# Autodesk Inventor assembly: Upright_Assembly_V2
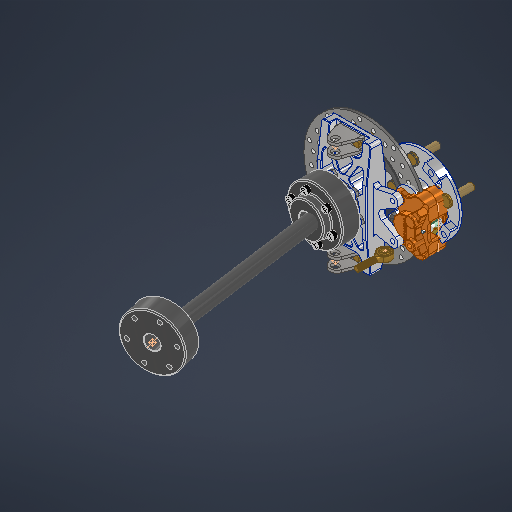
[picture p0: Inventor's stored thumbnail of the model, 512x512]
Saved by Autodesk Inventor 2027.1 (Build 311270010, 270A)
## iProperties
Created: 2026-10-10
Part Number: Upright_Assembly_V2
Document SubType Name: Assembly
Designer: share
Author: share
## Documents named in this file (21)
- C:\Users\share\OneDrive\Documents\Personal Projects\GOGO Kart\CAD\GOGO_KART_FSAE\Suspension - Shareef\Final Suspension Parts\REAL Upright\V2\Upright_Assembly_V2.iam
- C:\Users\share\OneDrive\Documents\Personal Projects\GOGO Kart\CAD\GOGO_KART_FSAE\Suspension - Shareef\Final Suspension Parts\REAL Upright\V2\grainger-35hz68.ipt
- C:\Users\share\OneDrive\Documents\Personal Projects\GOGO Kart\CAD\GOGO_KART_FSAE\Suspension - Shareef\Final Suspension Parts\REAL Upright\V2\Spindle_CV_Flange_V2.ipt
- C:\Users\share\OneDrive\Documents\Personal Projects\GOGO Kart\CAD\GOGO_KART_FSAE\Suspension - Shareef\Final Suspension Parts\REAL Upright\V2\Suspension_Upright_V2.ipt
- C:\Users\share\OneDrive\Documents\Personal Projects\GOGO Kart\CAD\GOGO_KART_FSAE\Suspension - Shareef\Final Suspension Parts\REAL Upright\V2\Wheel_Hub_V2.ipt
- C:\Users\share\OneDrive\Documents\Personal Projects\GOGO Kart\CAD\GOGO_KART_FSAE\Suspension - Shareef\Hardware\ALLSTAR 0.5 in Rod End Bracket (Rough).ipt
- C:\Users\share\OneDrive\Documents\Inventor\Content Center Files\R2026\en-US\ISO 4035(2)\ISO 4035 - M6 - ISO.ipt
- C:\Users\share\OneDrive\Documents\Inventor\Content Center Files\R2026\en-US\ISO 7089\ISO 7089 - 6 - 140 HV(1).ipt
- C:\Users\share\OneDrive\Documents\Inventor\Content Center Files\R2026\en-US\ISO 4018\ISO 4018 - M6 x 25.ipt
- C:\Users\share\OneDrive\Documents\Personal Projects\GOGO Kart\CAD\GOGO_KART_FSAE\Suspension - Shareef\Final Suspension Parts\REAL Upright\V2\F3_Brake_Rotor_V2.ipt
- C:\Users\share\OneDrive\Documents\Personal Projects\GOGO Kart\CAD\GOGO_KART_FSAE\Suspension - Shareef\Hardware\Lug Stud M12 X 45.ipt
- C:\Users\share\OneDrive\Documents\Inventor\Content Center Files\R2026\en-US\ISO 4018\ISO 4018 - M8 x 80.ipt
- C:\Users\share\OneDrive\Documents\Inventor\Content Center Files\R2026\en-US\ISO 7089\ISO 7089 - 8 - 140 HV(1).ipt
- C:\Users\share\OneDrive\Documents\Inventor\Content Center Files\R2026\en-US\ISO 4033(2)\ISO 4033 - M8 - ISO.ipt
- C:\Users\share\OneDrive\Documents\Personal Projects\GOGO Kart\CAD\GOGO_KART_FSAE\Suspension - Shareef\Final Suspension Parts\REAL Upright\V2\60645K141_Ball Joint Rod End (1).ipt
- C:\Users\share\OneDrive\Documents\Personal Projects\GOGO Kart\CAD\GOGO_KART_FSAE\Suspension - Shareef\hoosier-r25b-20x7-5-13-13-oz-aluminum-wheel-1.snapshot.2\Hoosier + OZ Rim.ipt
- C:\Users\share\OneDrive\Documents\Personal Projects\GOGO Kart\CAD\GOGO_KART_FSAE\Suspension - Shareef\Final Suspension Parts\REAL Upright\V2\Brake caliper-W-PS1.iam
- C:\Users\share\OneDrive\Documents\Inventor\Content Center Files\R2027\en-US\AS 1474(1)\AS 1474 - M8(1).ipt
- C:\Users\share\OneDrive\Documents\Personal Projects\GOGO Kart\CAD\GOGO_KART_FSAE\Drivetrain\CV Axles\Porsche_912_Standard_CV_Axle_Assembly.iam
- C:\Users\share\OneDrive\Documents\Personal Projects\GOGO Kart\CAD\GOGO_KART_FSAE\Drivetrain\CV Axles\CV_Flange_Bolt_V1.ipt
- C:\Users\share\OneDrive\Documents\Inventor\Content Center Files\R2027\en-US\AS 1237 (2.1)\AS 1237 - 8.ipt
## Components (50 placed, 20 different names)
1. grainger-35hz68:1 — Insert:38, Mate:21, Mate:22
2. grainger-35hz68:2 — Insert:39, Mate:23
3. Spindle_CV_Flange_V2:1 — Mate:7, Mate:13, Mate:15, Mate:16, Mate:19, Mate:21, Mate:22, Insert:50, Insert:51, Insert:52, Insert:65, Insert:66, Insert:67, Insert:68, Insert:69
4. Suspension_Upright_V2:1 — Flush:1, Flush:2, Flush:3, Insert:12, Insert:13, Insert:14, Insert:15, Insert:38, Insert:39, Insert:40, Insert:41, Insert:42, Insert:43, Insert:46, Insert:47
5. Wheel_Hub_V2:1 — Mate:6, Insert:22, Insert:23, Insert:24, Insert:25, Mate:13, Mate:18, Mate:20, Mate:23
6. ALLSTAR 0.5 in Rod End Bracket (Rough):1 — Insert:46, Insert:47, Insert:48, Insert:49
7. ALLSTAR 0.5 in Rod End Bracket (Rough):2 — Insert:42, Insert:43, Insert:44, Insert:45
8. ISO 4035 M6:1 — Insert:16
9. ISO 4035 M6:2 — Insert:17
10. ISO 4035 M6:3 — Insert:18
11. ISO 4035 M6:4 — Insert:19
12. ISO 7089 6:1 — Insert:15, Insert:19
13. ISO 7089 6:2 — Insert:14, Insert:18
14. ISO 7089 6:3 — Insert:13, Insert:16
15. ISO 7089 6:4 — Insert:12, Insert:17
16. ISO 4018 M6 x 25:1 — Insert:48
17. ISO 4018 M6 x 25:2 — Insert:49
18. ISO 4018 M6 x 25:3 — Insert:44
19. ISO 4018 M6 x 25:4 — Insert:45
20. F3_Brake_Rotor_V2:1 — Mate:4, Mate:6
21. Lug Stud M12 X 45:1 — Insert:24
22. Lug Stud M12 X 45:2 — Insert:25
23. Lug Stud M12 X 45:3 — Insert:23
24. Lug Stud M12 X 45:4 — Insert:22
25. ISO 4018 M8 x 80:1 — Insert:30, Mate:15, Mate:17
26. ISO 7089 8:1 — Insert:30, Mate:16
27. ISO 7089 8:2 — Mate:7, Insert:31, Mate:17, Mate:18
28. ISO 4033 M8:1 — Insert:31
29. 60645K141_Ball Joint Rod End (1):1
30. Hoosier + OZ Rim:1 — Mate:19, Mate:20
31. Brake caliper-W-PS1:1 [sub-assembly] — Insert:40, Insert:41
32. AS 1474 - Metric M8:1 — Insert:50
33. Porsche_912_Standard_CV_Axle_Assembly:1 [sub-assembly] — Insert:51, Insert:52, Insert:53, Insert:54, Insert:55, Insert:56, Insert:57, Insert:58
34. CV_Flange_Bolt_V1:1 — Insert:59
35. CV_Flange_Bolt_V1:2 — Insert:60
36. CV_Flange_Bolt_V1:3 — Insert:61
37. CV_Flange_Bolt_V1:4 — Insert:62
38. CV_Flange_Bolt_V1:5 — Insert:63
39. CV_Flange_Bolt_V1:6 — Insert:64
40. AS 1237 (2.1) 8:1 — Insert:53, Insert:60
41. AS 1237 (2.1) 8:2 — Insert:54, Insert:61
42. AS 1237 (2.1) 8:3 — Insert:55, Insert:59
43. AS 1237 (2.1) 8:4 — Insert:56, Insert:63
44. AS 1237 (2.1) 8:5 — Insert:57, Insert:64
45. AS 1237 (2.1) 8:6 — Insert:58, Insert:62
46. AS 1474 - Metric M8:2 — Insert:69
47. AS 1474 - Metric M8:3 — Insert:66
48. AS 1474 - Metric M8:4 — Insert:68
49. AS 1474 - Metric M8:5 — Insert:67
50. AS 1474 - Metric M8:6 — Insert:65
## Relationships (62: Insert 46, Mate 13, Flush 3)
- Flush:1: Suspension_Upright_V2:1
- Flush:2: Suspension_Upright_V2:1
- Flush:3: Suspension_Upright_V2:1
- Insert:12: Suspension_Upright_V2:1 ↔ ISO 7089 6:4
- Insert:13: Suspension_Upright_V2:1 ↔ ISO 7089 6:3
- Insert:14: Suspension_Upright_V2:1 ↔ ISO 7089 6:2
- Insert:15: Suspension_Upright_V2:1 ↔ ISO 7089 6:1
- Insert:16: ISO 4035 M6:1 ↔ ISO 7089 6:3
- Insert:17: ISO 4035 M6:2 ↔ ISO 7089 6:4
- Insert:18: ISO 4035 M6:3 ↔ ISO 7089 6:2
- Insert:19: ISO 4035 M6:4 ↔ ISO 7089 6:1
- Mate:4: F3_Brake_Rotor_V2:1
- Mate:6: Wheel_Hub_V2:1 ↔ F3_Brake_Rotor_V2:1
- Insert:22: Wheel_Hub_V2:1 ↔ Lug Stud M12 X 45:4
- Insert:23: Wheel_Hub_V2:1 ↔ Lug Stud M12 X 45:3
- Insert:24: Wheel_Hub_V2:1 ↔ Lug Stud M12 X 45:1
- Insert:25: Wheel_Hub_V2:1 ↔ Lug Stud M12 X 45:2
- Mate:7: Spindle_CV_Flange_V2:1 ↔ ISO 7089 8:2
- Insert:30: ISO 4018 M8 x 80:1 ↔ ISO 7089 8:1
- Insert:31: ISO 7089 8:2 ↔ ISO 4033 M8:1
- Mate:13: Spindle_CV_Flange_V2:1 ↔ Wheel_Hub_V2:1
- Mate:15: Spindle_CV_Flange_V2:1 ↔ ISO 4018 M8 x 80:1
- Mate:16: Spindle_CV_Flange_V2:1 ↔ ISO 7089 8:1
- Mate:17: ISO 4018 M8 x 80:1 ↔ ISO 7089 8:2
- Mate:18: Wheel_Hub_V2:1 ↔ ISO 7089 8:2
- Mate:19: Spindle_CV_Flange_V2:1 ↔ Hoosier + OZ Rim:1
- Mate:20: Wheel_Hub_V2:1 ↔ Hoosier + OZ Rim:1
- Insert:38: grainger-35hz68:1 ↔ Suspension_Upright_V2:1
- Insert:39: grainger-35hz68:2 ↔ Suspension_Upright_V2:1
- Mate:21: grainger-35hz68:1 ↔ Spindle_CV_Flange_V2:1
- Mate:22: grainger-35hz68:1 ↔ Spindle_CV_Flange_V2:1
- Mate:23: grainger-35hz68:2 ↔ Wheel_Hub_V2:1
- Insert:40: Suspension_Upright_V2:1 ↔ Brake caliper-W-PS1:1
- Insert:41: Suspension_Upright_V2:1 ↔ Brake caliper-W-PS1:1
- Insert:42: Suspension_Upright_V2:1 ↔ ALLSTAR 0.5 in Rod End Bracket (Rough):2
- Insert:43: Suspension_Upright_V2:1 ↔ ALLSTAR 0.5 in Rod End Bracket (Rough):2
- Insert:44: ALLSTAR 0.5 in Rod End Bracket (Rough):2 ↔ ISO 4018 M6 x 25:3
- Insert:45: ALLSTAR 0.5 in Rod End Bracket (Rough):2 ↔ ISO 4018 M6 x 25:4
- Insert:46: Suspension_Upright_V2:1 ↔ ALLSTAR 0.5 in Rod End Bracket (Rough):1
- Insert:47: Suspension_Upright_V2:1 ↔ ALLSTAR 0.5 in Rod End Bracket (Rough):1
- Insert:48: ALLSTAR 0.5 in Rod End Bracket (Rough):1 ↔ ISO 4018 M6 x 25:1
- Insert:49: ALLSTAR 0.5 in Rod End Bracket (Rough):1 ↔ ISO 4018 M6 x 25:2
- Insert:50: Spindle_CV_Flange_V2:1 ↔ AS 1474 - Metric M8:1
- Insert:51: Spindle_CV_Flange_V2:1 ↔ Porsche_912_Standard_CV_Axle_Assembly:1
- Insert:52: Spindle_CV_Flange_V2:1 ↔ Porsche_912_Standard_CV_Axle_Assembly:1
- Insert:53: Porsche_912_Standard_CV_Axle_Assembly:1 ↔ AS 1237 (2.1) 8:1
- Insert:54: Porsche_912_Standard_CV_Axle_Assembly:1 ↔ AS 1237 (2.1) 8:2
- Insert:55: Porsche_912_Standard_CV_Axle_Assembly:1 ↔ AS 1237 (2.1) 8:3
- Insert:56: Porsche_912_Standard_CV_Axle_Assembly:1 ↔ AS 1237 (2.1) 8:4
- Insert:57: Porsche_912_Standard_CV_Axle_Assembly:1 ↔ AS 1237 (2.1) 8:5
- Insert:58: Porsche_912_Standard_CV_Axle_Assembly:1 ↔ AS 1237 (2.1) 8:6
- Insert:59: CV_Flange_Bolt_V1:1 ↔ AS 1237 (2.1) 8:3
- Insert:60: CV_Flange_Bolt_V1:2 ↔ AS 1237 (2.1) 8:1
- Insert:61: CV_Flange_Bolt_V1:3 ↔ AS 1237 (2.1) 8:2
- Insert:62: CV_Flange_Bolt_V1:4 ↔ AS 1237 (2.1) 8:6
- Insert:63: CV_Flange_Bolt_V1:5 ↔ AS 1237 (2.1) 8:4
- Insert:64: CV_Flange_Bolt_V1:6 ↔ AS 1237 (2.1) 8:5
- Insert:65: Spindle_CV_Flange_V2:1 ↔ AS 1474 - Metric M8:6
- Insert:66: Spindle_CV_Flange_V2:1 ↔ AS 1474 - Metric M8:3
- Insert:67: Spindle_CV_Flange_V2:1 ↔ AS 1474 - Metric M8:5
- Insert:68: Spindle_CV_Flange_V2:1 ↔ AS 1474 - Metric M8:4
- Insert:69: Spindle_CV_Flange_V2:1 ↔ AS 1474 - Metric M8:2
